# Autodesk Inventor assembly: M20 Gland
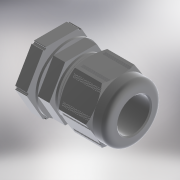
[picture p0: Inventor's stored thumbnail of the model, 180x180]
Saved by Autodesk Inventor 2018 (Build 220112000, 112)
## iProperties
Created: 2017-09-06
Part Number: M20 Gland
Document SubType Name: Assembly
Designer: callum
Author: callum
## Documents named in this file (4)
- D:\Documents\Design\CAD PARTS\Glands\M20 Gland\M20 Gland.iam
- D:\Documents\Design\CAD PARTS\Glands\M20 Gland\M20 Body.ipt
- D:\Documents\Design\CAD PARTS\Glands\M20 Gland\M20 Nut.ipt
- D:\Documents\Design\CAD PARTS\Glands\M20 Gland\M20 Lock Nut.ipt
## Components (3 placed, 3 different names)
1. M20 Body:1 — Mate:1, Flush:1, Mate:2, Mate:3, Angle:1, Angle:2, Mate:4, Tangent:1, Flush:2
2. M20 Nut:1 — Mate:1, Flush:1, Angle:1
3. M20 Lock Nut:1 — Mate:2, Mate:3, Angle:2
## Relationships (9: Mate 4, Flush 2, Angle 2, Tangent 1)
- Mate:1: M20 Body:1 ↔ M20 Nut:1
- Flush:1 (-2 mm): M20 Body:1 ↔ M20 Nut:1
- Mate:2: M20 Body:1 ↔ M20 Lock Nut:1
- Mate:3 (2 mm): M20 Body:1 ↔ M20 Lock Nut:1
- Angle:1 (0 deg): M20 Body:1 ↔ M20 Nut:1
- Angle:2 (0 deg): M20 Body:1 ↔ M20 Lock Nut:1
- Mate:4: M20 Body:1
- Tangent:1: M20 Body:1
- Flush:2: M20 Body:1
